# Autodesk Inventor assembly: File Kelompok 3
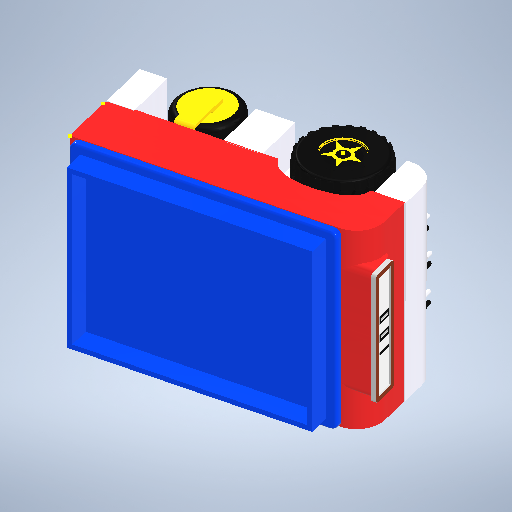
[picture p0: Inventor's stored thumbnail of the model, 512x512]
Saved by Autodesk Inventor 2025 (Build 290162000, 162)
## iProperties
Created: 2026-01-01
Part Number: File Kelompok 3
Document SubType Name: Assembly
Designer: novsa
Mass: 1666.18 g
Surface Area: 4056.2 cm^2
Volume: 1666.18 cm^3
Density: 1 g/cm^3
Author: novsa
## Documents named in this file (19)
- C:\Users\novsa.4SUS\Downloads\File Kelompok 3.iam
- C:\Users\novsa.4SUS\OneDrive\Dokumen\Sasis Robot.ipt
- C:\Users\novsa.4SUS\OneDrive\Dokumen\Motor Robot.ipt
- C:\Users\novsa.4SUS\OneDrive\Dokumen\LCD.ipt
- C:\Users\novsa.4SUS\OneDrive\Dokumen\Timbangan Robot.ipt
- C:\Users\novsa.4SUS\OneDrive\Dokumen\rotasi agv.ipt
- C:\Users\novsa.4SUS\OneDrive\Dokumen\bodt bawah.ipt
- C:\Users\novsa.4SUS\Downloads\Body AGV 2.ipt
- C:\Users\novsa.4SUS\Downloads\Roda AGV.0002.ipt
- C:\Users\novsa.4SUS\Downloads\Penyangga fr.ipt
- C:\Users\novsa.4SUS\Downloads\roda freewell.ipt
- C:\Users\novsa.4SUS\OneDrive\Dokumen\led.ipt
- C:\Users\novsa.4SUS\Downloads\LOAD CELL.ipt
- C:\Users\novsa.4SUS\Downloads\File Kelompok 3\AIP\FEA\farh60in4.fins
- C:\Users\novsa.4SUS\Downloads\File Kelompok 3\AIP\FEA\farh60io0.fsat
- C:\Users\novsa.4SUS\Downloads\File Kelompok 3\AIP\FEA\farh60io0.ftes
- C:\Users\novsa.4SUS\Downloads\File Kelompok 3\AIP\FEA\farh60io0.fwiz
- C:\Users\novsa.4SUS\Downloads\File Kelompok 3\AIP\FEA\farh60isg.fmsh
- C:\Users\novsa.4SUS\Downloads\File Kelompok 3\AIP\FEA\farh60itc.fres
## Components (23 placed, 12 different names)
1. Sasis Robot:1 — Insert:1, Insert:6, Insert:10, Insert:12
2. Motor Robot:1 — Insert:1, Insert:7, Insert:10, Insert:22
3. Motor Robot:2 — Insert:6, Insert:11, Insert:12
4. LCD:1 — Rigid:1
5. Timbangan Robot:3
6. rotasi agv:1 — Insert:13
7. rotasi agv:2 — Insert:17
8. bodt bawah:1 — Mate:1, Mate:2, Mate:3, Mate:4, Mate:5, Mate:6
9. Body AGV 2:7 — Mate:7, Rigid:1
10. Roda AGV.0002:1 — Insert:11
11. Roda AGV.0002:2 — Insert:7, Insert:22
12. Penyangga fr:1 — Insert:13, Insert:19, Insert:21
13. Penyangga fr:2 — Insert:17, Insert:18, Insert:20
14. led:1
15. led:16 — Mate:3
16. led:17 — Mate:2
17. led:18 — Mate:1
18. led:19 — Mate:4
19. led:20 — Mate:5
20. led:21 — Mate:6
21. roda freewell:1 — Insert:18, Insert:20
22. roda freewell:2 — Insert:19, Insert:21
23. LOAD CELL:2 — Mate:7
## Relationships (21: Insert 13, Mate 7, WeldJoint 1)
- Insert:1: Sasis Robot:1 ↔ Motor Robot:1
- Insert:6: Sasis Robot:1 ↔ Motor Robot:2
- Insert:7: Motor Robot:1 ↔ Roda AGV.0002:2
- Insert:10: Sasis Robot:1 ↔ Motor Robot:1
- Insert:11: Motor Robot:2 ↔ Roda AGV.0002:1
- Insert:12: Sasis Robot:1 ↔ Motor Robot:2
- Insert:13: rotasi agv:1 ↔ Penyangga fr:1
- Mate:1: bodt bawah:1 ↔ led:18
- Mate:2: bodt bawah:1 ↔ led:17
- Mate:3: bodt bawah:1 ↔ led:16
- Mate:4: bodt bawah:1 ↔ led:19
- Mate:5: bodt bawah:1 ↔ led:20
- Mate:6: bodt bawah:1 ↔ led:21
- Insert:17: rotasi agv:2 ↔ Penyangga fr:2
- Insert:18: Penyangga fr:2 ↔ roda freewell:1
- Insert:19: Penyangga fr:1 ↔ roda freewell:2
- Mate:7: Body AGV 2:7 ↔ LOAD CELL:2
- Rigid:1 [WeldJoint]: LCD:1 ↔ Body AGV 2:7
- Insert:20: Penyangga fr:2 ↔ roda freewell:1
- Insert:21: Penyangga fr:1 ↔ roda freewell:2
- Insert:22: Motor Robot:1 ↔ Roda AGV.0002:2
## Named parameters: sa_0 = 1500
note: some values were not read from the file. Shown as the stored number, unit unknown: "sa_0".
